# Autodesk Inventor assembly: 01_ASM_Chassis_proto
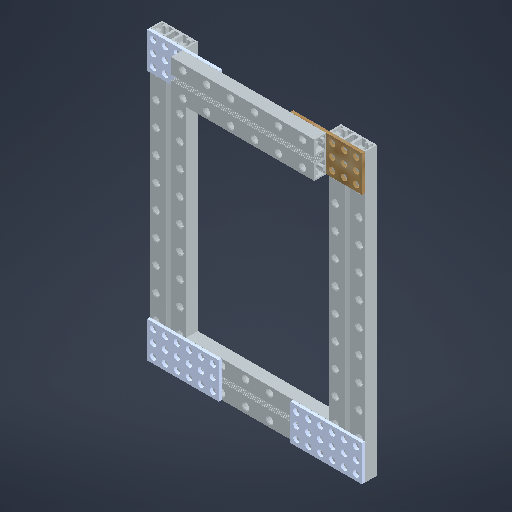
[picture p0: Inventor's stored thumbnail of the model, 512x512]
Saved by Autodesk Inventor 2026 (Build 300175000, 175)
## iProperties
Created: 2025-04-30
Part Number: 01_ASM_Chassis_proto
Document SubType Name: Assembly
Designer: AdminForWorker
Title: 01_ASM_Chassis_proto v1
Author: AdminForWorker
## Documents named in this file (4)
- C:\Users\virgi\OneDrive - HESSO\Fichiers de Guerinet Rémi - P2511_Dossier_partage_RVEZ\01_Robot\0101_CAO\0_Châssis\01_Petit Châssis\01_ASM_Chassis_proto.iam
- C:\Users\virgi\OneDrive - HESSO\Fichiers de Guerinet Rémi - P2511_Dossier_partage_RVEZ\01_Robot\0101_CAO\0_Châssis\01_Petit Châssis\01_3_Profilés_bleus_192mm v1.ipt
- C:\Users\virgi\OneDrive - HESSO\Fichiers de Guerinet Rémi - P2511_Dossier_partage_RVEZ\01_Robot\0101_CAO\0_Châssis\01_Petit Châssis\01_1_Plaque_bleue_3x6 v1.ipt
- C:\Users\virgi\OneDrive - HESSO\Fichiers de Guerinet Rémi - P2511_Dossier_partage_RVEZ\01_Robot\0101_CAO\0_Châssis\01_Petit Châssis\01_2_Profilés_bleus_96mm v1.ipt
## Components (8 placed, 3 different names)
1. 01_3_Profilés_bleus_192mm v1:1 — Affleurement:1, Placage:1, Affleurement:2, Placage:2, Affleurement:3, Affleurement:4, Placage:3, Affleurement:6, Placage:6
2. 01_1_Plaque_bleue_3x6 v1:1 — Affleurement:1, Placage:1, Affleurement:2, Placage:5, Affleurement:7
3. 01_2_Profilés_bleus_96mm v1:1 — Placage:5, Placage:6, Affleurement:7, Placage:10, Affleurement:11
4. 01_3_Profilés_bleus_192mm v1:2 — Placage:8, Affleurement:9, Placage:9, Affleurement:10, Placage:11, Affleurement:12
5. 01_2_Profilés_bleus_96mm v1:2 — Placage:3, Affleurement:6, Placage:4, Placage:7, Affleurement:8, Placage:8, Affleurement:9
6. 01_1_Plaque_bleue_3x6 v1:2 — Placage:10, Placage:11, Affleurement:11, Affleurement:12
7. 01_1_Plaque_bleue_3x6 v1:3 — Placage:2, Affleurement:3, Affleurement:4, Placage:4
8. 01_1_Plaque_bleue_3x6 v1:4 — Placage:7, Affleurement:8, Placage:9, Affleurement:10
## Relationships (22: Flush 11, Mate 11)
- Affleurement:1 [Flush]: 01_3_Profilés_bleus_192mm v1:1 ↔ 01_1_Plaque_bleue_3x6 v1:1
- Placage:1 [Mate]: 01_3_Profilés_bleus_192mm v1:1 ↔ 01_1_Plaque_bleue_3x6 v1:1
- Affleurement:2 [Flush]: 01_3_Profilés_bleus_192mm v1:1 ↔ 01_1_Plaque_bleue_3x6 v1:1
- Placage:2 [Mate]: 01_3_Profilés_bleus_192mm v1:1 ↔ 01_1_Plaque_bleue_3x6 v1:3
- Affleurement:3 [Flush]: 01_3_Profilés_bleus_192mm v1:1 ↔ 01_1_Plaque_bleue_3x6 v1:3
- Affleurement:4 [Flush]: 01_3_Profilés_bleus_192mm v1:1 ↔ 01_1_Plaque_bleue_3x6 v1:3
- Placage:3 [Mate]: 01_3_Profilés_bleus_192mm v1:1 ↔ 01_2_Profilés_bleus_96mm v1:2
- Affleurement:6 [Flush]: 01_3_Profilés_bleus_192mm v1:1 ↔ 01_2_Profilés_bleus_96mm v1:2
- Placage:4 [Mate]: 01_2_Profilés_bleus_96mm v1:2 ↔ 01_1_Plaque_bleue_3x6 v1:3
- Placage:5 [Mate]: 01_1_Plaque_bleue_3x6 v1:1 ↔ 01_2_Profilés_bleus_96mm v1:1
- Placage:6 [Mate]: 01_3_Profilés_bleus_192mm v1:1 ↔ 01_2_Profilés_bleus_96mm v1:1
- Affleurement:7 [Flush]: 01_1_Plaque_bleue_3x6 v1:1 ↔ 01_2_Profilés_bleus_96mm v1:1
- Placage:7 [Mate]: 01_2_Profilés_bleus_96mm v1:2 ↔ 01_1_Plaque_bleue_3x6 v1:4
- Affleurement:8 [Flush]: 01_2_Profilés_bleus_96mm v1:2 ↔ 01_1_Plaque_bleue_3x6 v1:4
- Placage:8 [Mate]: 01_3_Profilés_bleus_192mm v1:2 ↔ 01_2_Profilés_bleus_96mm v1:2
- Affleurement:9 [Flush]: 01_3_Profilés_bleus_192mm v1:2 ↔ 01_2_Profilés_bleus_96mm v1:2
- Placage:9 [Mate]: 01_3_Profilés_bleus_192mm v1:2 ↔ 01_1_Plaque_bleue_3x6 v1:4
- Affleurement:10 [Flush]: 01_3_Profilés_bleus_192mm v1:2 ↔ 01_1_Plaque_bleue_3x6 v1:4
- Placage:10 [Mate]: 01_2_Profilés_bleus_96mm v1:1 ↔ 01_1_Plaque_bleue_3x6 v1:2
- Placage:11 [Mate]: 01_3_Profilés_bleus_192mm v1:2 ↔ 01_1_Plaque_bleue_3x6 v1:2
- Affleurement:11 [Flush]: 01_2_Profilés_bleus_96mm v1:1 ↔ 01_1_Plaque_bleue_3x6 v1:2
- Affleurement:12 [Flush]: 01_3_Profilés_bleus_192mm v1:2 ↔ 01_1_Plaque_bleue_3x6 v1:2
